# Autodesk Inventor assembly: as_delmate
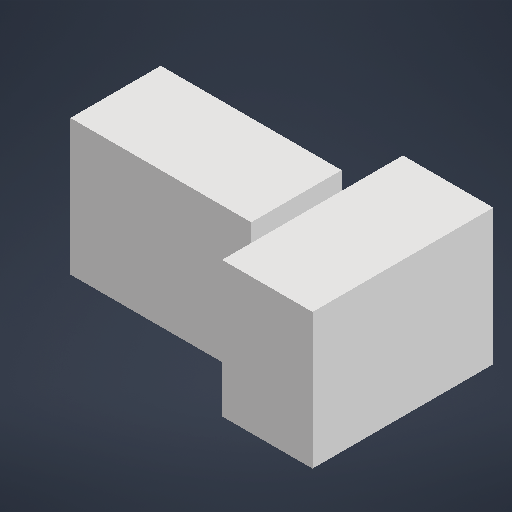
[picture p0: Inventor's stored thumbnail of the model, 512x512]
Saved by Autodesk Inventor 2027 (Build 310192060, 192F)
## iProperties
Created: 2026-10-20
Part Number: as_delmate
Document SubType Name: Assembly
Designer: vmiguel
Author: vmiguel
## Documents named in this file (2)
- C:\Users\vmiguel\git\inventor-interface\writer\fixtures\spec\as_delmate.iam
- C:\Users\vmiguel\git\inventor-interface\writer\fixtures\spec\ex_rect20.ipt
## Components (2 placed, 1 different names)
1. ex_rect20:1 — Mate:1
2. ex_rect20:2 — Mate:1
## Relationships (1: Mate 1)
- Mate:1 (5 mm): ex_rect20:1 ↔ ex_rect20:2
